# Autodesk Inventor assembly: ASM_petit_Robot
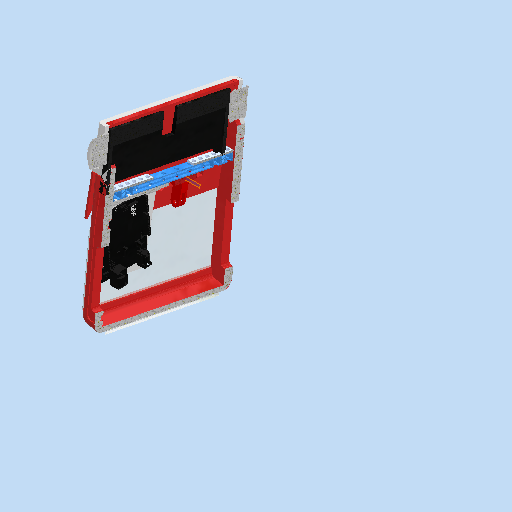
[picture p0: Inventor's stored thumbnail of the model, 512x512]
Saved by Autodesk Inventor 2026 (Build 300175050, 175E)
## iProperties
Created: 2025-05-02
Part Number: ASM_petit_Robot
Document SubType Name: Assembly
Designer: virgi
Author: virgi
## Documents named in this file (14)
- C:\Users\karle\OneDrive - HESSO\P2511_Dossier_partage_RVEZ\01_Robot\0101_CAO\ASM_petit_Robot.iam
- C:\Users\karle\OneDrive - HESSO\P2511_Dossier_partage_RVEZ\01_Robot\0101_CAO\0_Châssis\01_Petit Châssis\01_ASM_Chassis_proto.iam
- C:\Users\karle\OneDrive - HESSO\P2511_Dossier_partage_RVEZ\01_Robot\0101_CAO\Moteur\Modelcraft RB350030-0A101R\Modelcraft RB350030-0A101R\Modelcraft RB350030-0A101R.ipt
- C:\Users\karle\OneDrive - HESSO\P2511_Dossier_partage_RVEZ\01_Robot\0101_CAO\4_Bobine\4_04_asm_Bobine.iam
- C:\Users\karle\OneDrive - HESSO\P2511_Dossier_partage_RVEZ\01_Robot\0101_CAO\4_Bobine\support_de_maintient_incline_tuyau.ipt
- C:\Users\karle\OneDrive - HESSO\P2511_Dossier_partage_RVEZ\01_Robot\0101_CAO\Moteur\Modelcraft RB350030-0A101R\Arduino-UNO.ipt
- C:\Users\karle\OneDrive - HESSO\P2511_Dossier_partage_RVEZ\01_Robot\0101_CAO\Moteur\Batterie_7.2V.ipt
- C:\Users\karle\OneDrive - HESSO\P2511_Dossier_partage_RVEZ\01_Robot\0101_CAO\0_Châssis\01_Petit Châssis\01_6_axe_petit_robot_v1.ipt
- C:\Users\karle\OneDrive - HESSO\P2511_Dossier_partage_RVEZ\01_Robot\0101_CAO\Moteur\roues_3d_moteur_axe_petit_robot.ipt
- C:\Users\karle\OneDrive - HESSO\P2511_Dossier_partage_RVEZ\01_Robot\0101_CAO\Moteur\roues_3d_moteur_petit_robot.ipt
- C:\Users\karle\OneDrive - HESSO\P2511_Dossier_partage_RVEZ\01_Robot\0101_CAO\Moteur\roues_3d_moteur_tpu_petit_robot.ipt
- C:\Users\karle\OneDrive - HESSO\P2511_Dossier_partage_RVEZ\01_Robot\0101_CAO\0_Châssis\01_Petit Châssis\01_4_2_support_electronique_moteur.ipt
- C:\Users\karle\OneDrive - HESSO\P2511_Dossier_partage_RVEZ\01_Robot\0101_CAO\0_Châssis\01_Petit Châssis\01_4_3_support_electronique.ipt
- C:\Users\karle\OneDrive - HESSO\P2511_Dossier_partage_RVEZ\01_Robot\0101_CAO\7_esthétique\7_0_ASM_esthetique_PR.iam
## Components (19 placed, 13 different names)
1. 01_ASM_Chassis_proto:1 [sub-assembly] — Passend:43, Passend:44, Passend:45, Passend:48, Passend:49, Passend:102, Passend:104, Fluchtend:106, Passend:105, Passend:123, Passend:124, Passend:125, Passend:127, Passend:128, Passend:129, Passend:132
2. 4_04_asm_Bobine:1 [sub-assembly] — Passend:127, Passend:128, Passend:129
3. support_de_maintient_incline_tuyau:1 — Passend:48, Passend:49, Passend:102
4. support_de_maintient_incline_tuyau:2 — Passend:43, Passend:44, Passend:45
5. Arduino-UNO:1 — Passend:126, Passend:130
6. Batterie_7.2V:1 — Passend:109, Passend:115, Passend:116
7. Batterie_7.2V:2 — Passend:108, Passend:113, Passend:114
8. Modelcraft RB350030-0A101R:1 — Einfügen:1, Passend:120, Passend:121, Passend:122
9. Modelcraft RB350030-0A101R:2 — Einfügen:2, Passend:117, Passend:118, Passend:119
10. 01_6_axe_petit_robot_v1:1 — Einfügen:4, Einfügen:5, Passend:106
11. roues_3d_moteur_axe_petit_robot:1 — Einfügen:5
12. roues_3d_moteur_petit_robot:1 — Einfügen:1, Einfügen:3
13. roues_3d_moteur_tpu_petit_robot:1 — Einfügen:6
14. roues_3d_moteur_axe_petit_robot:2 — Einfügen:4, Passend:107
15. roues_3d_moteur_petit_robot:2 — Einfügen:2, Einfügen:6
16. roues_3d_moteur_tpu_petit_robot:2 — Einfügen:3
17. 01_4_2_support_electronique_moteur:1 — Passend:104, Fluchtend:106, Passend:105, Passend:106, Passend:107, Passend:108, Passend:109, Passend:113, Passend:114, Passend:115, Passend:116, Passend:117, Passend:118, Passend:119, Passend:120, Passend:121, Passend:122, Passend:131, Fluchtend:107
18. 01_4_3_support_electronique:1 — Passend:123, Passend:124, Passend:125, Passend:126, Passend:130
19. 7_0_ASM_esthetique_PR:1 [sub-assembly] — Passend:131, Fluchtend:107, Passend:132
## Relationships (40: Mate 32, Insert 6, Flush 2)
- Passend:43 [Mate]: 01_ASM_Chassis_proto:1 ↔ support_de_maintient_incline_tuyau:2
- Passend:44 [Mate]: 01_ASM_Chassis_proto:1 ↔ support_de_maintient_incline_tuyau:2
- Passend:45 [Mate]: 01_ASM_Chassis_proto:1 ↔ support_de_maintient_incline_tuyau:2
- Passend:48 [Mate]: 01_ASM_Chassis_proto:1 ↔ support_de_maintient_incline_tuyau:1
- Passend:49 [Mate]: 01_ASM_Chassis_proto:1 ↔ support_de_maintient_incline_tuyau:1
- Passend:102 [Mate]: 01_ASM_Chassis_proto:1 ↔ support_de_maintient_incline_tuyau:1
- Einfügen:1 [Insert]: Modelcraft RB350030-0A101R:1 ↔ roues_3d_moteur_petit_robot:1
- Einfügen:2 [Insert]: Modelcraft RB350030-0A101R:2 ↔ roues_3d_moteur_petit_robot:2
- Einfügen:3 [Insert]: roues_3d_moteur_petit_robot:1 ↔ roues_3d_moteur_tpu_petit_robot:2
- Einfügen:4 [Insert]: 01_6_axe_petit_robot_v1:1 ↔ roues_3d_moteur_axe_petit_robot:2
- Einfügen:5 [Insert]: 01_6_axe_petit_robot_v1:1 ↔ roues_3d_moteur_axe_petit_robot:1
- Einfügen:6 [Insert]: roues_3d_moteur_tpu_petit_robot:1 ↔ roues_3d_moteur_petit_robot:2
- Passend:104 [Mate]: 01_ASM_Chassis_proto:1 ↔ 01_4_2_support_electronique_moteur:1
- Fluchtend:106 [Flush]: 01_ASM_Chassis_proto:1 ↔ 01_4_2_support_electronique_moteur:1
- Passend:105 [Mate]: 01_ASM_Chassis_proto:1 ↔ 01_4_2_support_electronique_moteur:1
- Passend:106 [Mate]: 01_6_axe_petit_robot_v1:1 ↔ 01_4_2_support_electronique_moteur:1
- Passend:107 [Mate] (15 mm): roues_3d_moteur_axe_petit_robot:2 ↔ 01_4_2_support_electronique_moteur:1
- Passend:108 [Mate]: Batterie_7.2V:2 ↔ 01_4_2_support_electronique_moteur:1
- Passend:109 [Mate]: Batterie_7.2V:1 ↔ 01_4_2_support_electronique_moteur:1
- Passend:113 [Mate]: Batterie_7.2V:2 ↔ 01_4_2_support_electronique_moteur:1
- Passend:114 [Mate] (55 mm): Batterie_7.2V:2 ↔ 01_4_2_support_electronique_moteur:1
- Passend:115 [Mate] (55 mm): Batterie_7.2V:1 ↔ 01_4_2_support_electronique_moteur:1
- Passend:116 [Mate]: Batterie_7.2V:1 ↔ 01_4_2_support_electronique_moteur:1
- Passend:117 [Mate]: Modelcraft RB350030-0A101R:2 ↔ 01_4_2_support_electronique_moteur:1
- Passend:118 [Mate]: Modelcraft RB350030-0A101R:2 ↔ 01_4_2_support_electronique_moteur:1
- Passend:119 [Mate]: Modelcraft RB350030-0A101R:2 ↔ 01_4_2_support_electronique_moteur:1
- Passend:120 [Mate]: Modelcraft RB350030-0A101R:1 ↔ 01_4_2_support_electronique_moteur:1
- Passend:121 [Mate]: Modelcraft RB350030-0A101R:1 ↔ 01_4_2_support_electronique_moteur:1
- Passend:122 [Mate]: Modelcraft RB350030-0A101R:1 ↔ 01_4_2_support_electronique_moteur:1
- Passend:123 [Mate]: 01_ASM_Chassis_proto:1 ↔ 01_4_3_support_electronique:1
- Passend:124 [Mate]: 01_ASM_Chassis_proto:1 ↔ 01_4_3_support_electronique:1
- Passend:125 [Mate]: 01_ASM_Chassis_proto:1 ↔ 01_4_3_support_electronique:1
- Passend:126 [Mate]: Arduino-UNO:1 ↔ 01_4_3_support_electronique:1
- Passend:127 [Mate]: 01_ASM_Chassis_proto:1 ↔ 4_04_asm_Bobine:1
- Passend:128 [Mate]: 01_ASM_Chassis_proto:1 ↔ 4_04_asm_Bobine:1
- Passend:129 [Mate]: 01_ASM_Chassis_proto:1 ↔ 4_04_asm_Bobine:1
- Passend:130 [Mate]: Arduino-UNO:1 ↔ 01_4_3_support_electronique:1
- Passend:131 [Mate] (4 mm): 01_4_2_support_electronique_moteur:1 ↔ 7_0_ASM_esthetique_PR:1
- Fluchtend:107 [Flush]: 01_4_2_support_electronique_moteur:1 ↔ 7_0_ASM_esthetique_PR:1
- Passend:132 [Mate]: 01_ASM_Chassis_proto:1 ↔ 7_0_ASM_esthetique_PR:1
